# Autodesk Inventor assembly: BaseBox
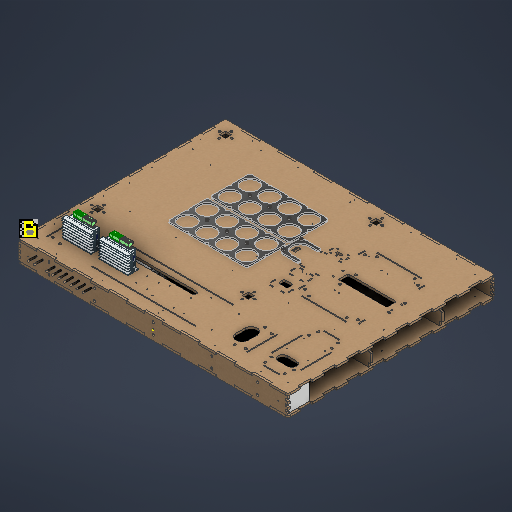
[picture p0: Inventor's stored thumbnail of the model, 512x512]
Saved by Autodesk Inventor 2027.1 (Build 311270010, 270A)
## iProperties
Created: 2026-10-13
Part Number: BaseBox
Document SubType Name: Assembly
Designer: SDS Scholar
Author: SDS Scholar
## Documents named in this file (18)
- C:\Users\Ahmed\Desktop\Fall 26\Design 1 Repo\MCT333_Design_of_Mechatronics_Systems_1\CAD\boxes\base_box\BaseBox.iam
- C:\Users\Ahmed\Desktop\Fall 26\Design 1 Repo\MCT333_Design_of_Mechatronics_Systems_1\CAD\boxes\base_box\ProductsStoringGrid.ipt
- C:\Users\Ahmed\Desktop\Fall 26\Design 1 Repo\MCT333_Design_of_Mechatronics_Systems_1\CAD\boxes\base_box\BaseBoxLengthFace.ipt
- C:\Users\Ahmed\Desktop\Fall 26\Design 1 Repo\MCT333_Design_of_Mechatronics_Systems_1\CAD\boxes\base_box\BaseSupports.ipt
- C:\Users\Ahmed\Desktop\Fall 26\Design 1 Repo\MCT333_Design_of_Mechatronics_Systems_1\CAD\boxes\base_box\LowerBase.ipt
- C:\Users\Ahmed\Desktop\Fall 26\Design 1 Repo\MCT333_Design_of_Mechatronics_Systems_1\CAD\boxes\base_box\Magazine.ipt
- C:\Users\Ahmed\Desktop\Fall 26\Design 1 Repo\MCT333_Design_of_Mechatronics_Systems_1\CAD\electronic_components\power-supply-300-to-360w\360W Supply\360W Supply.ipt
- C:\Users\Ahmed\Desktop\Fall 26\Design 1 Repo\MCT333_Design_of_Mechatronics_Systems_1\CAD\boxes\base_box\BaseBoxWidthFace2.ipt
- C:\Users\Ahmed\Desktop\Fall 26\Design 1 Repo\MCT333_Design_of_Mechatronics_Systems_1\CAD\boxes\base_box\BaseBoxWidthFace1.ipt
- C:\Users\Ahmed\Documents\Inventor\Content Center Files\R2027\en-US\ANSI B18.22 M\ANSI B18.22M - 5 N.ipt
- C:\Users\Ahmed\Desktop\Fall 26\Design 1 Repo\MCT333_Design_of_Mechatronics_Systems_1\CAD\fastners\nuts\ANSI B 18.2.4.1 M - M5 x 0.8Style 1.ipt
- C:\Users\Ahmed\Documents\Inventor\Content Center Files\R2027\en-US\ISO 4762(2)\ISO 4762 - M5 x 20ISO.ipt
- C:\Users\Ahmed\Desktop\Fall 26\Design 1 Repo\MCT333_Design_of_Mechatronics_Systems_1\CAD\electronic_components\mini-on-off-rocker-switch-2-pins\small_MA_switch_b\small_MA_switch_b.ipt
- C:\Users\Ahmed\Desktop\Fall 26\Design 1 Repo\MCT333_Design_of_Mechatronics_Systems_1\CAD\cartesian_robot_workspace\Ir.iam
- C:\Users\Ahmed\Desktop\Fall 26\Design 1 Repo\MCT333_Design_of_Mechatronics_Systems_1\CAD\boxes\base_box\upper_base.ipt
- C:\Users\Ahmed\Desktop\Fall 26\Design 1 Repo\MCT333_Design_of_Mechatronics_Systems_1\CAD\motors_and_actuators\smakn-tb6600-stepper-motor-driver\SMAKN TB6600 Stepper Motor Driver\SMAKN TB6600 Stepper Motor Driver.ipt
- C:\Users\Ahmed\Desktop\Fall 26\Design 1 Repo\MCT333_Design_of_Mechatronics_Systems_1\CAD\boxes\base_box\wood_log.ipt
- C:\Users\Ahmed\Desktop\Fall 26\Design 1 Repo\MCT333_Design_of_Mechatronics_Systems_1\CAD\DESIGN1_CAD_parameters.xlsx
## Components (41 placed, 16 different names)
1. upper_base:1 — Flush:28, Flush:30, Flush:31, Flush:20, Flush:32, Flush:33, Mate:48, Mate:49, Mate:50, Mate:52, Mate:55, Mate:56, Mate:57, Flush:36, Flush:38, Flush:39, Flush:41, Mate:61, Mate:62, Mate:63, Flush:46, Mate:69, Mate:70, Mate:71
2. ProductsStoringGrid:1 — Mate:33, Mate:34, Mate:48, Mate:51
3. ProductsStoringGrid:2 — Mate:49, Mate:53, Mate:54
4. BaseBoxLengthFace:1 — Flush:39, Flush:40, Flush:41, Mate:59
5. BaseBoxLengthFace:2 — Flush:15, Mate:26, Flush:36, Flush:37, Flush:38, Mate:60, Mate:65
6. BaseBoxWidthFace1:1 — Flush:20, Flush:27, Mate:47, Flush:32, Flush:33, Mate:66
7. BaseBoxWidthFace2:1 — Flush:28, Flush:30, Flush:31, Flush:34, Flush:35, Flush:37, Flush:40, Flush:42, Flush:43, Flush:44, Flush:45
8. BaseSupports:1 — Mate:59, Flush:42, Flush:43
9. BaseSupports:2 — Mate:60, Flush:44, Flush:45
10. LowerBase:1 — Flush:15, Mate:27, Flush:22, Flush:27, Flush:34, Flush:35, Mate:64, Mate:67, Mate:68
11. Magazine:1 — Mate:39, Mate:40, Mate:57, Mate:58
12. 360W Supply:1 — Mate:27, Mate:26, Flush:22
13. small_MA_switch_b:1 — Mate:47, Mate:66
14. Ir:17 [sub-assembly] — Mate:67, Mate:68
15. SMAKN TB6600 Stepper Motor Driver:1 — Mate:61, Mate:62, Mate:63
16. wood_log:1 — Mate:64, Mate:65, Flush:46
17. SMAKN TB6600 Stepper Motor Driver:2 — Mate:69, Mate:70, Mate:71
18. ISO 4762 M5 x 20:1 — Mate:33, Mate:34, Mate:35, Mate:37, Mate:50
19. Plain Washer (Metric) 5 N:1 — Mate:35, Mate:38
20. Hex Nut Metric M5 x 0.8:1 — Mate:37, Mate:38
21. ISO 4762 M5 x 20:2 — Mate:53
22. Plain Washer (Metric) 5 N:2
23. Hex Nut Metric M5 x 0.8:2
24. ISO 4762 M5 x 20:3
25. Plain Washer (Metric) 5 N:3
26. Hex Nut Metric M5 x 0.8:3
27. ISO 4762 M5 x 20:4
28. Plain Washer (Metric) 5 N:4
29. Hex Nut Metric M5 x 0.8:4
30. ISO 4762 M5 x 20:5 — Mate:51, Mate:52
31. Plain Washer (Metric) 5 N:5
32. Hex Nut Metric M5 x 0.8:5
33. ISO 4762 M5 x 20:6 — Mate:54
34. Plain Washer (Metric) 5 N:6
35. Hex Nut Metric M5 x 0.8:6
36. ISO 4762 M5 x 20:7 — Mate:39, Mate:40, Mate:44, Mate:56
37. Plain Washer (Metric) 5 N:7 — Mate:43
38. Hex Nut Metric M5 x 0.8:7 — Mate:43, Mate:44
39. ISO 4762 M5 x 20:8 — Mate:55, Mate:58
40. Plain Washer (Metric) 5 N:8
41. Hex Nut Metric M5 x 0.8:8
## Component patterns: (6 elements, first: ISO 4762 M5 x 20:1 + Plain Washer (Metric) 5 N:1 + Hex Nut Metric M5 x 0.8:1), (2 elements, first: ISO 4762 M5 x 20:7 + Plain Washer (Metric) 5 N:7 + Hex Nut Metric M5 x 0.8:7)
## Relationships (61: Mate 36, Flush 25)
- [Flush]: upper_base:1
- [Flush]: upper_base:1
- [Flush]: upper_base:1
- Flush:15: BaseBoxLengthFace:2 ↔ LowerBase:1
- Flush:20: upper_base:1 ↔ BaseBoxWidthFace1:1
- Mate:27: LowerBase:1 ↔ 360W Supply:1
- Mate:26 (100 mm): BaseBoxLengthFace:2 ↔ 360W Supply:1
- Flush:22 (80 mm): LowerBase:1 ↔ 360W Supply:1
- Flush:27: BaseBoxWidthFace1:1 ↔ LowerBase:1
- Flush:28: upper_base:1 ↔ BaseBoxWidthFace2:1
- Flush:30: upper_base:1 ↔ BaseBoxWidthFace2:1
- Mate:33: ProductsStoringGrid:1 ↔ ISO 4762 M5 x 20:1
- Mate:34: ProductsStoringGrid:1 ↔ ISO 4762 M5 x 20:1
- Mate:35: ISO 4762 M5 x 20:1 ↔ Plain Washer (Metric) 5 N:1
- Mate:37: ISO 4762 M5 x 20:1 ↔ Hex Nut Metric M5 x 0.8:1
- Mate:38: Plain Washer (Metric) 5 N:1 ↔ Hex Nut Metric M5 x 0.8:1
- Mate:39: Magazine:1 ↔ ISO 4762 M5 x 20:7
- Mate:40: Magazine:1 ↔ ISO 4762 M5 x 20:7
- Mate:43: Plain Washer (Metric) 5 N:7 ↔ Hex Nut Metric M5 x 0.8:7
- Mate:44: ISO 4762 M5 x 20:7 ↔ Hex Nut Metric M5 x 0.8:7
- Mate:47: BaseBoxWidthFace1:1 ↔ small_MA_switch_b:1
- Flush:31: upper_base:1 ↔ BaseBoxWidthFace2:1
- Flush:32: upper_base:1 ↔ BaseBoxWidthFace1:1
- Flush:33: upper_base:1 ↔ BaseBoxWidthFace1:1
- Mate:48: upper_base:1 ↔ ProductsStoringGrid:1
- Mate:49: upper_base:1 ↔ ProductsStoringGrid:2
- Mate:50: upper_base:1 ↔ ISO 4762 M5 x 20:1
- Mate:51: ProductsStoringGrid:1 ↔ ISO 4762 M5 x 20:5
- Mate:52: upper_base:1 ↔ ISO 4762 M5 x 20:5
- Mate:53: ProductsStoringGrid:2 ↔ ISO 4762 M5 x 20:2
- Mate:54: ProductsStoringGrid:2 ↔ ISO 4762 M5 x 20:6
- Mate:55: upper_base:1 ↔ ISO 4762 M5 x 20:8
- Mate:56: upper_base:1 ↔ ISO 4762 M5 x 20:7
- Mate:57: upper_base:1 ↔ Magazine:1
- Mate:58: Magazine:1 ↔ ISO 4762 M5 x 20:8
- Flush:34: BaseBoxWidthFace2:1 ↔ LowerBase:1
- Flush:35: BaseBoxWidthFace2:1 ↔ LowerBase:1
- Flush:36: upper_base:1 ↔ BaseBoxLengthFace:2
- Flush:37: BaseBoxLengthFace:2 ↔ BaseBoxWidthFace2:1
- Flush:38: upper_base:1 ↔ BaseBoxLengthFace:2
- Flush:39: upper_base:1 ↔ BaseBoxLengthFace:1
- Flush:40: BaseBoxLengthFace:1 ↔ BaseBoxWidthFace2:1
- Flush:41: upper_base:1 ↔ BaseBoxLengthFace:1
- Mate:59 (160 mm): BaseBoxLengthFace:1 ↔ BaseSupports:1
- Flush:42: BaseBoxWidthFace2:1 ↔ BaseSupports:1
- Flush:43: BaseBoxWidthFace2:1 ↔ BaseSupports:1
- Mate:60 (265 mm): BaseBoxLengthFace:2 ↔ BaseSupports:2
- Flush:44: BaseBoxWidthFace2:1 ↔ BaseSupports:2
- Flush:45: BaseBoxWidthFace2:1 ↔ BaseSupports:2
- Mate:61: upper_base:1 ↔ SMAKN TB6600 Stepper Motor Driver:1
- Mate:62: upper_base:1 ↔ SMAKN TB6600 Stepper Motor Driver:1
- Mate:63: upper_base:1 ↔ SMAKN TB6600 Stepper Motor Driver:1
- Mate:64: LowerBase:1 ↔ wood_log:1
- Mate:65: BaseBoxLengthFace:2 ↔ wood_log:1
- Flush:46: upper_base:1 ↔ wood_log:1
- Mate:66: BaseBoxWidthFace1:1 ↔ small_MA_switch_b:1
- Mate:67: LowerBase:1 ↔ Ir:17
- Mate:68: LowerBase:1 ↔ Ir:17
- Mate:69: upper_base:1 ↔ SMAKN TB6600 Stepper Motor Driver:2
- Mate:70: upper_base:1 ↔ SMAKN TB6600 Stepper Motor Driver:2
- Mate:71: upper_base:1 ↔ SMAKN TB6600 Stepper Motor Driver:2
## Named parameters: Product_dia = 50 mm, ProductBaseHeight = 40 mm, ProductLedHeight = 20 mm, GridProcutClearance = 5 mm, GridBorderThickness = 5 mm, GridBorderFillets = 7 mm, GridTotalSize = 65 mm, GridRobotClearance = 65 mm, AluminiumExtrusionBase = 20 mm, AluminiumExtrusionClearance = 35 mm, BaseTotalWidth = 680 mm, FeedingAreaLength = 340 mm, BaseTotalLength = 885 mm, DistanceBetweenGrid = 10 mm, WorkspaceLength = 515 mm, WorkspaceWidth = 440 mm, WorkspaceHeight = 183 mm, AxesBaseFillet = 15 mm, Zaxis = 197 mm, ProductTotalHeight = 45 mm, VerticalClearance = 20 mm, VerticalStroke = 105 mm, FrontArea = 50 mm, BackArea = 165 mm, CylinderStroke = 75 mm, SideAreaWidth = 200 mm, BaseHeight = 70 mm, BoxesClearance = 40 mm, BoxesWidth = 125 mm, PowerBoxLength = 660 mm, PneumaticBoxLength = 200 mm, ContolBoxLength = 100 mm, DistanceBetweenBoxes = 30 mm, BoxesHeight = 80 mm, ContolBoxWidth = 200 mm, ControlBoxHeight = 70 mm, BaseWoodThickness = 7 mm, kerf = 1.5 mm, Kerf = 0.3 mm, TransmitterAreaWidth = 100 mm, RxThickness = 1.8 mm, support_2 = 265 mm, support_1 = 160 mm, wood_log = 50 mm
